# Autodesk Inventor assembly: Mecanismo_original_MG90S_cruz
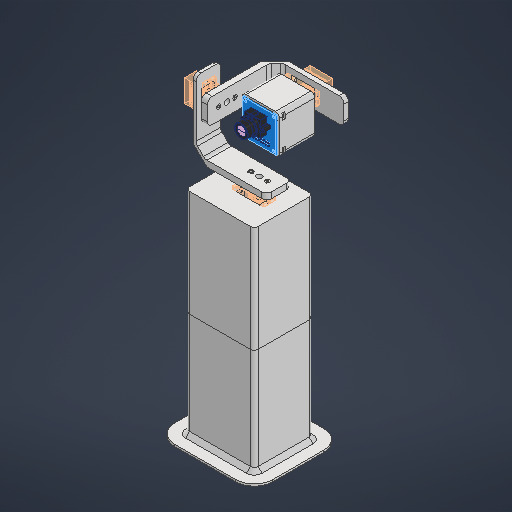
[picture p0: Inventor's stored thumbnail of the model, 512x512]
Saved by Autodesk Inventor 2027.2 (Build 312334000, 334)
## iProperties
Created: 2026-11-15
Part Number: Mecanismo_original_MG90S_cruz
Document SubType Name: Assembly
Designer: alexa
Author: alexa
Comments: Variante del mecanismo original; MG90S, cruz de referencia 32.1 x 21 mm, aletas 1.4 mm, huella 1.6 mm con holgura nominal 0.2 mm por lado. Medidas fisicas de la cruz no disponibles; usar brazo comercial suministrado. Para pernos M2 ampliar los agujeros del brazo plastico a 2 mm. Tuercas M2 y M3 con alojamientos y acceso; camara: 4 M3x8. Centro mecanico nominal (10.15,286,0) mm. Geometria y masa verificadas en CAD; no ensayo fisico. PETG macizo 1.27 g/cm3, camara 20 g, servos 13.4 g y margen 0.06 kgf.cm por cableado/fijaciones.
## Documents named in this file (11)
- C:\Users\alexa\tesis-star-tracker\Inventor\Mecanismo_3GDL\Mecanismo_original_MG90S_cruz\Mecanismo_original_MG90S_cruz.iam
- C:\Users\alexa\tesis-star-tracker\Inventor\Mecanismo_3GDL\Mecanismo_original_MG90S_cruz\01_Base_original_MG90S.ipt
- C:\Users\alexa\tesis-star-tracker\Inventor\Mecanismo_3GDL\Mecanismo_original_MG90S_cruz\02_L_yaw_MG90S.ipt
- C:\Users\alexa\tesis-star-tracker\Inventor\Mecanismo_3GDL\Mecanismo_original_MG90S_cruz\03_L_pitch_MG90S.ipt
- C:\Users\alexa\tesis-star-tracker\Inventor\Mecanismo_3GDL\Mecanismo_original_MG90S_cruz\04_Portacamara_M3_cruz.ipt
- C:\Users\alexa\tesis-star-tracker\Inventor\Mecanismo_3GDL\Mecanismo_original_MG90S_cruz\MG90S_referencia.ipt
- C:\Users\alexa\tesis-star-tracker\Inventor\Mecanismo_3GDL\Mecanismo_original_MG90S_cruz\Brazo_cruz_MG90S_referencia.ipt
- C:\Users\alexa\tesis-star-tracker\Inventor\Mecanismo_3GDL\Mecanismo_original_MG90S_cruz\OV7670_referencia.ipt
- C:\Users\alexa\tesis-star-tracker\Inventor\Mecanismo_3GDL\Mecanismo_original_MG90S_cruz\Tuerca_M2_referencia.ipt
- C:\Users\alexa\tesis-star-tracker\Inventor\Mecanismo_3GDL\Mecanismo_original_MG90S_cruz\Tuerca_M3_referencia.ipt
- C:\Users\alexa\tesis-star-tracker\Inventor\Mecanismo_3GDL\Mecanismo_original_MG90S_cruz\01_Base_original_MG90S_CPY1.ipt
## Components (28 placed, 28 different names)
1. Base — Yaw_coaxial, Yaw_axial, Giro_Yaw, Nivelación:4, Nivelación:5, Nivelación:6, Nivelación:25, Nivelación:26, Nivelación:27, Nivelación:43, Nivelación:44, Nivelación:45, Nivelación:73, Nivelación:74, Coincidencia:4
2. L_yaw — Yaw_coaxial, Yaw_axial, Giro_Yaw, Pitch_coaxial, Pitch_axial, Giro_Pitch, Nivelación:7, Nivelación:8, Nivelación:9, Nivelación:13, Nivelación:14, Nivelación:15, Nivelación:28, Nivelación:29, Nivelación:30, Nivelación:34, Nivelación:35, Nivelación:36, Nivelación:46, Nivelación:47, Nivelación:48, Nivelación:52, Nivelación:53, Nivelación:54
3. L_pitch — Pitch_coaxial, Pitch_axial, Giro_Pitch, Roll_coaxial, Roll_axial, Giro_Roll, Nivelación:10, Nivelación:11, Nivelación:12, Nivelación:16, Nivelación:17, Nivelación:18, Nivelación:31, Nivelación:32, Nivelación:33, Nivelación:37, Nivelación:38, Nivelación:39, Nivelación:49, Nivelación:50, Nivelación:51, Nivelación:55, Nivelación:56, Nivelación:57
4. Portacamara — Roll_coaxial, Roll_axial, Giro_Roll, Nivelación:19, Nivelación:20, Nivelación:21, Nivelación:22, Nivelación:23, Nivelación:24, Nivelación:40, Nivelación:41, Nivelación:42, Nivelación:58, Nivelación:59, Nivelación:60, Nivelación:61, Nivelación:62, Nivelación:63, Nivelación:64, Nivelación:65, Nivelación:66, Nivelación:67, Nivelación:68, Nivelación:69, Nivelación:70, Nivelación:71, Nivelación:72
5. Servo_yaw — Nivelación:4, Nivelación:5, Nivelación:6
6. Servo_pitch — Nivelación:7, Nivelación:8, Nivelación:9
7. Servo_roll — Nivelación:10, Nivelación:11, Nivelación:12
8. Cruz_yaw — Nivelación:13, Nivelación:14, Nivelación:15
9. Cruz_pitch — Nivelación:16, Nivelación:17, Nivelación:18
10. Cruz_roll — Nivelación:19, Nivelación:20, Nivelación:21
11. OV7670 — Nivelación:22, Nivelación:23, Nivelación:24
12. M2_motor_yaw_0 — Nivelación:25, Nivelación:26, Nivelación:27
13. M2_motor_pitch_0 — Nivelación:28, Nivelación:29, Nivelación:30
14. M2_motor_roll_0 — Nivelación:31, Nivelación:32, Nivelación:33
15. M2_cruz_yaw_0 — Nivelación:34, Nivelación:35, Nivelación:36
16. M2_cruz_pitch_0 — Nivelación:37, Nivelación:38, Nivelación:39
17. M2_cruz_roll_0 — Nivelación:40, Nivelación:41, Nivelación:42
18. M2_motor_yaw_1 — Nivelación:43, Nivelación:44, Nivelación:45
19. M2_motor_pitch_1 — Nivelación:46, Nivelación:47, Nivelación:48
20. M2_motor_roll_1 — Nivelación:49, Nivelación:50, Nivelación:51
21. M2_cruz_yaw_1 — Nivelación:52, Nivelación:53, Nivelación:54
22. M2_cruz_pitch_1 — Nivelación:55, Nivelación:56, Nivelación:57
23. M2_cruz_roll_1 — Nivelación:58, Nivelación:59, Nivelación:60
24. M3_camara_0 — Nivelación:61, Nivelación:62, Nivelación:63
25. M3_camara_1 — Nivelación:64, Nivelación:65, Nivelación:66
26. M3_camara_2 — Nivelación:67, Nivelación:68, Nivelación:69
27. M3_camara_3 — Nivelación:70, Nivelación:71, Nivelación:72
28. 01_Base_original_MG90S_CPY1:1 — Nivelación:73, Nivelación:74, Coincidencia:4
## Relationships (81: Flush 74, Mate 4, Angle 3)
- Yaw_coaxial [Mate]: Base ↔ L_yaw
- Yaw_axial [Flush]: Base ↔ L_yaw
- Giro_Yaw [Angle] (0 deg): Base ↔ L_yaw
- Pitch_coaxial [Mate]: L_yaw ↔ L_pitch
- Pitch_axial [Flush]: L_yaw ↔ L_pitch
- Giro_Pitch [Angle] (0 deg): L_yaw ↔ L_pitch
- Roll_coaxial [Mate]: L_pitch ↔ Portacamara
- Roll_axial [Flush]: L_pitch ↔ Portacamara
- Giro_Roll [Angle] (0 deg): L_pitch ↔ Portacamara
- Nivelación:4 [Flush]: Base ↔ Servo_yaw
- Nivelación:5 [Flush]: Base ↔ Servo_yaw
- Nivelación:6 [Flush]: Base ↔ Servo_yaw
- Nivelación:7 [Flush]: L_yaw ↔ Servo_pitch
- Nivelación:8 [Flush]: L_yaw ↔ Servo_pitch
- Nivelación:9 [Flush]: L_yaw ↔ Servo_pitch
- Nivelación:10 [Flush]: L_pitch ↔ Servo_roll
- Nivelación:11 [Flush]: L_pitch ↔ Servo_roll
- Nivelación:12 [Flush]: L_pitch ↔ Servo_roll
- Nivelación:13 [Flush]: L_yaw ↔ Cruz_yaw
- Nivelación:14 [Flush]: L_yaw ↔ Cruz_yaw
- Nivelación:15 [Flush]: L_yaw ↔ Cruz_yaw
- Nivelación:16 [Flush]: L_pitch ↔ Cruz_pitch
- Nivelación:17 [Flush]: L_pitch ↔ Cruz_pitch
- Nivelación:18 [Flush]: L_pitch ↔ Cruz_pitch
- Nivelación:19 [Flush]: Portacamara ↔ Cruz_roll
- Nivelación:20 [Flush]: Portacamara ↔ Cruz_roll
- Nivelación:21 [Flush]: Portacamara ↔ Cruz_roll
- Nivelación:22 [Flush]: Portacamara ↔ OV7670
- Nivelación:23 [Flush]: Portacamara ↔ OV7670
- Nivelación:24 [Flush]: Portacamara ↔ OV7670
- Nivelación:25 [Flush]: Base ↔ M2_motor_yaw_0
- Nivelación:26 [Flush]: Base ↔ M2_motor_yaw_0
- Nivelación:27 [Flush]: Base ↔ M2_motor_yaw_0
- Nivelación:28 [Flush]: L_yaw ↔ M2_motor_pitch_0
- Nivelación:29 [Flush]: L_yaw ↔ M2_motor_pitch_0
- Nivelación:30 [Flush]: L_yaw ↔ M2_motor_pitch_0
- Nivelación:31 [Flush]: L_pitch ↔ M2_motor_roll_0
- Nivelación:32 [Flush]: L_pitch ↔ M2_motor_roll_0
- Nivelación:33 [Flush]: L_pitch ↔ M2_motor_roll_0
- Nivelación:34 [Flush]: L_yaw ↔ M2_cruz_yaw_0
- Nivelación:35 [Flush]: L_yaw ↔ M2_cruz_yaw_0
- Nivelación:36 [Flush]: L_yaw ↔ M2_cruz_yaw_0
- Nivelación:37 [Flush]: L_pitch ↔ M2_cruz_pitch_0
- Nivelación:38 [Flush]: L_pitch ↔ M2_cruz_pitch_0
- Nivelación:39 [Flush]: L_pitch ↔ M2_cruz_pitch_0
- Nivelación:40 [Flush]: Portacamara ↔ M2_cruz_roll_0
- Nivelación:41 [Flush]: Portacamara ↔ M2_cruz_roll_0
- Nivelación:42 [Flush]: Portacamara ↔ M2_cruz_roll_0
- Nivelación:43 [Flush]: Base ↔ M2_motor_yaw_1
- Nivelación:44 [Flush]: Base ↔ M2_motor_yaw_1
- Nivelación:45 [Flush]: Base ↔ M2_motor_yaw_1
- Nivelación:46 [Flush]: L_yaw ↔ M2_motor_pitch_1
- Nivelación:47 [Flush]: L_yaw ↔ M2_motor_pitch_1
- Nivelación:48 [Flush]: L_yaw ↔ M2_motor_pitch_1
- Nivelación:49 [Flush]: L_pitch ↔ M2_motor_roll_1
- Nivelación:50 [Flush]: L_pitch ↔ M2_motor_roll_1
- Nivelación:51 [Flush]: L_pitch ↔ M2_motor_roll_1
- Nivelación:52 [Flush]: L_yaw ↔ M2_cruz_yaw_1
- Nivelación:53 [Flush]: L_yaw ↔ M2_cruz_yaw_1
- Nivelación:54 [Flush]: L_yaw ↔ M2_cruz_yaw_1
- Nivelación:55 [Flush]: L_pitch ↔ M2_cruz_pitch_1
- Nivelación:56 [Flush]: L_pitch ↔ M2_cruz_pitch_1
- Nivelación:57 [Flush]: L_pitch ↔ M2_cruz_pitch_1
- Nivelación:58 [Flush]: Portacamara ↔ M2_cruz_roll_1
- Nivelación:59 [Flush]: Portacamara ↔ M2_cruz_roll_1
- Nivelación:60 [Flush]: Portacamara ↔ M2_cruz_roll_1
- Nivelación:61 [Flush]: Portacamara ↔ M3_camara_0
- Nivelación:62 [Flush]: Portacamara ↔ M3_camara_0
- Nivelación:63 [Flush]: Portacamara ↔ M3_camara_0
- Nivelación:64 [Flush]: Portacamara ↔ M3_camara_1
- Nivelación:65 [Flush]: Portacamara ↔ M3_camara_1
- Nivelación:66 [Flush]: Portacamara ↔ M3_camara_1
- Nivelación:67 [Flush]: Portacamara ↔ M3_camara_2
- Nivelación:68 [Flush]: Portacamara ↔ M3_camara_2
- Nivelación:69 [Flush]: Portacamara ↔ M3_camara_2
- Nivelación:70 [Flush]: Portacamara ↔ M3_camara_3
- Nivelación:71 [Flush]: Portacamara ↔ M3_camara_3
- Nivelación:72 [Flush]: Portacamara ↔ M3_camara_3
- Nivelación:73 [Flush]: Base ↔ 01_Base_original_MG90S_CPY1:1
- Nivelación:74 [Flush]: Base ↔ 01_Base_original_MG90S_CPY1:1
- Coincidencia:4 [Mate]: Base ↔ 01_Base_original_MG90S_CPY1:1
## Named parameters: Altura_centro_lente = 286 mm, Par_pitch_estimado_kgfcm = 0.21985, Par_roll_estimado_kgfcm = 0.0661208, Masa_movil_yaw = 0.107569, Yaw_negativo_libre = 90 deg, Yaw_positivo_libre = 90 deg, Pitch_negativo_libre = 90 deg, Pitch_positivo_libre = 61 deg, Roll_negativo_libre = 90 deg, Roll_positivo_libre = 90 deg
note: some values were not read from the file. Shown as the stored number, unit unknown: "Masa_movil_yaw".
